# Autodesk Inventor assembly: Optics Test Jig
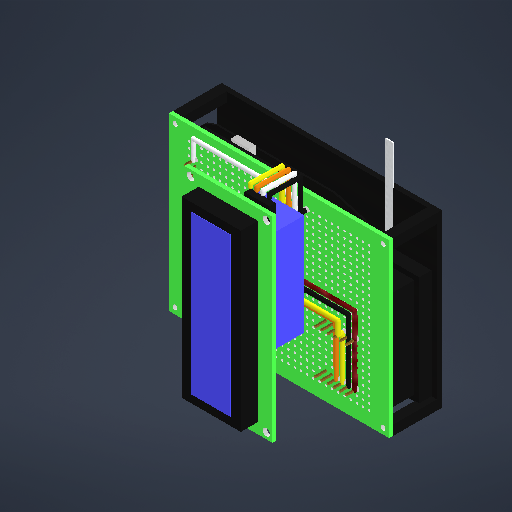
[picture p0: Inventor's stored thumbnail of the model, 512x512]
Saved by Autodesk Inventor 2027.2 (Build 312334000, 334)
## iProperties
Created: 2026-11-11
Part Number: Optics Test Jig
Description: Optics test jig: electronics on the sled with one optical module, a pouch and an LFA strip
Document SubType Name: Assembly
Designer: isaac
Author: isaac
## Documents named in this file (6)
- C:\Users\isaac\Optical-Sensing-Device\hardware\enclosure\Optics Test Jig.iam
- C:\Users\isaac\Optical-Sensing-Device\hardware\enclosure\Electronics Assembly.iam
- C:\Users\isaac\Optical-Sensing-Device\hardware\enclosure\Test Jig\Test Sled.ipt
- C:\Users\isaac\Optical-Sensing-Device\hardware\enclosure\Test Jig\Optical Module d1.6.ipt
- C:\Users\isaac\Optical-Sensing-Device\hardware\enclosure\Purchased Parts\DetectaChem\MobileDetect Pouch.ipt
- C:\Users\isaac\Optical-Sensing-Device\hardware\enclosure\Test Strips\LFA Strip (bare).ipt
## Components (5 placed, 5 different names)
1. Electronics Assembly:1 [sub-assembly]
2. Test Sled:1
3. Optical Module d1.6:1
4. MobileDetect Pouch:1 — Pouch on floor, Pouch centred, Pouch insertion
5. LFA Strip (bare):1 — Strip on floor, Strip centred, Strip insertion
## Relationships (6: Flush 4, Mate 2)
- Pouch on floor [Flush]: MobileDetect Pouch:1
- Pouch centred [Mate]: MobileDetect Pouch:1
- Pouch insertion [Flush]: MobileDetect Pouch:1
- Strip on floor [Flush]: LFA Strip (bare):1
- Strip centred [Mate]: LFA Strip (bare):1
- Strip insertion [Flush]: LFA Strip (bare):1
## Named parameters: Insertion = 0 mm, InsertionMin = 0 mm, InsertionMax = 95 mm, StripInsertion = 0 mm, StripInsertionMin = 0 mm, StripInsertionMax = 80 mm
